# Autodesk Inventor assembly: XM430-W350-R_MIR1
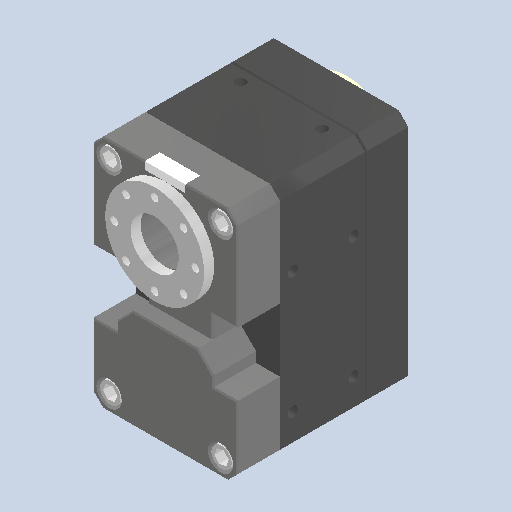
[picture p0: Inventor's stored thumbnail of the model, 512x512]
Saved by Autodesk Inventor 2025.2 (Build 292293000, 293)
## iProperties
Created: 2018-07-05
Part Number: XM430-W350-R_MIR1
Document SubType Name: Assembly
Designer: ricoa
Title: /vol/tmp/translate-329079067709669955/5b3e80553a1eeb103c565669.step
Revision Number: NONE
## Documents named in this file (17)
- C:\Users\ricoa\OneDrive\Desktop\PROYEK AKHIR\project_pororo\XM430-W350-R\XM430-W350-R\XM430-W350-R_MIR1.iam
- C:\Users\ricoa\OneDrive\Desktop\PROYEK AKHIR\project_pororo\XM430-W350-R\XM430-W350-R\Part 1_MIR1.ipt
- C:\Users\ricoa\OneDrive\Desktop\PROYEK AKHIR\project_pororo\XM430-W350-R\XM430-W350-R\Part 2_MIR1.ipt
- C:\Users\ricoa\OneDrive\Desktop\PROYEK AKHIR\project_pororo\XM430-W350-R\XM430-W350-R\Part 3_MIR1.ipt
- C:\Users\ricoa\OneDrive\Desktop\PROYEK AKHIR\project_pororo\XM430-W350-R\XM430-W350-R\Part 4_MIR1.ipt
- C:\Users\ricoa\OneDrive\Desktop\PROYEK AKHIR\project_pororo\XM430-W350-R\XM430-W350-R\Part 5_MIR1.ipt
- C:\Users\ricoa\OneDrive\Desktop\PROYEK AKHIR\project_pororo\XM430-W350-R\XM430-W350-R\Part 6_MIR1.ipt
- C:\Users\ricoa\OneDrive\Desktop\PROYEK AKHIR\project_pororo\XM430-W350-R\XM430-W350-R\Part 7_MIR1.ipt
- C:\Users\ricoa\OneDrive\Desktop\PROYEK AKHIR\project_pororo\XM430-W350-R\XM430-W350-R\Part 8_MIR1.ipt
- C:\Users\ricoa\OneDrive\Desktop\PROYEK AKHIR\project_pororo\XM430-W350-R\XM430-W350-R\Part 9_MIR1.ipt
- C:\Users\ricoa\OneDrive\Desktop\PROYEK AKHIR\project_pororo\XM430-W350-R\XM430-W350-R\Part 10_MIR1.ipt
- C:\Users\ricoa\OneDrive\Desktop\PROYEK AKHIR\project_pororo\XM430-W350-R\XM430-W350-R\Part 11_MIR1.ipt
- C:\Users\ricoa\OneDrive\Desktop\PROYEK AKHIR\project_pororo\XM430-W350-R\XM430-W350-R\Part 12_MIR1.ipt
- C:\Users\ricoa\OneDrive\Desktop\PROYEK AKHIR\project_pororo\XM430-W350-R\XM430-W350-R\Part 13_MIR1.ipt
- C:\Users\ricoa\OneDrive\Desktop\PROYEK AKHIR\project_pororo\XM430-W350-R\XM430-W350-R\Part 14_MIR1.ipt
- C:\Users\ricoa\OneDrive\Desktop\PROYEK AKHIR\project_pororo\XM430-W350-R\XM430-W350-R\Part 15_MIR1.ipt
- C:\Users\ricoa\OneDrive\Desktop\PROYEK AKHIR\project_pororo\XM430-W350-R\XM430-W350-R\Part 16_MIR1.ipt
## Components (16 placed, 16 different names)
1. Part 1_MIR1:1 — Mate:2, Mate:1
2. Part 2_MIR1:1
3. Part 3_MIR1:1
4. Part 4_MIR1:1 — Mate:2, Mate:1
5. Part 5_MIR1:1
6. Part 6_MIR1:1
7. Part 7_MIR1:1
8. Part 8_MIR1:1
9. Part 9_MIR1:1
10. Part 10_MIR1:1
11. Part 11_MIR1:1
12. Part 12_MIR1:1
13. Part 13_MIR1:1
14. Part 14_MIR1:1
15. Part 15_MIR1:1
16. Part 16_MIR1:1
## Relationships (2: Mate 2)
- Mate:2: Part 1_MIR1:1 ↔ Part 4_MIR1:1
- Mate:1: Part 1_MIR1:1 ↔ Part 4_MIR1:1
